# Autodesk Inventor assembly: fillet-edges4
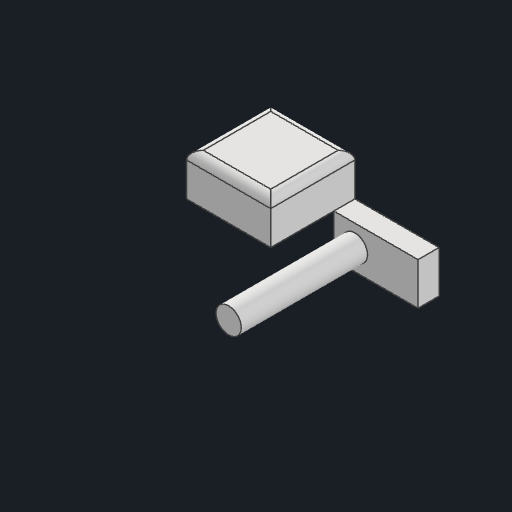
[picture p0: Inventor's stored thumbnail of the model, 512x512]
Saved by Autodesk Inventor 2026.1 (Build 301233000, 233)
## iProperties
Created: 2026-10-30
Part Number: fillet-edges4
Document SubType Name: Assembly
Designer: anony
Author: anony
## Documents named in this file (4)
- C:\Users\anony\OneDrive\Desktop\AI Projects\CAD Convert\corpus\generated\asmgrip\fillet-edges4.iam
- C:\Users\anony\OneDrive\Desktop\AI Projects\CAD Convert\corpus\generated\asmparts\box.ipt
- C:\Users\anony\OneDrive\Desktop\AI Projects\CAD Convert\corpus\generated\asmparts\pin.ipt
- C:\Users\anony\OneDrive\Desktop\AI Projects\CAD Convert\corpus\generated\fillet\edges4.ipt
## Components (3 placed, 3 different names)
1. box:1 — Mate:5, Mate:6, Mate:7, Mate:8, Mate:9, Mate:10, Mate:11, Mate:12, Mate:13, Mate:14, Mate:15, Mate:16, Mate:17, Mate:18, Mate:19, Mate:20
2. pin:1 — Mate:1, Mate:2, Mate:3, Mate:4
3. edges4:1 — Mate:1, Mate:2, Mate:3, Mate:4, Mate:5, Mate:6, Mate:7, Mate:8, Mate:9, Mate:10, Mate:11, Mate:12, Mate:13, Mate:14, Mate:15, Mate:16, Mate:17, Mate:18, Mate:19, Mate:20
## Relationships (20: Mate 20)
- Mate:1: pin:1 ↔ edges4:1
- Mate:2: pin:1 ↔ edges4:1
- Mate:3: pin:1 ↔ edges4:1
- Mate:4: pin:1 ↔ edges4:1
- Mate:5: box:1 ↔ edges4:1
- Mate:6: box:1 ↔ edges4:1
- Mate:7: box:1 ↔ edges4:1
- Mate:8: box:1 ↔ edges4:1
- Mate:9: box:1 ↔ edges4:1
- Mate:10: box:1 ↔ edges4:1
- Mate:11: box:1 ↔ edges4:1
- Mate:12: box:1 ↔ edges4:1
- Mate:13: box:1 ↔ edges4:1
- Mate:14: box:1 ↔ edges4:1
- Mate:15: box:1 ↔ edges4:1
- Mate:16: box:1 ↔ edges4:1
- Mate:17: box:1 ↔ edges4:1
- Mate:18: box:1 ↔ edges4:1
- Mate:19: box:1 ↔ edges4:1
- Mate:20: box:1 ↔ edges4:1
